# Autodesk Inventor assembly: Assembly1
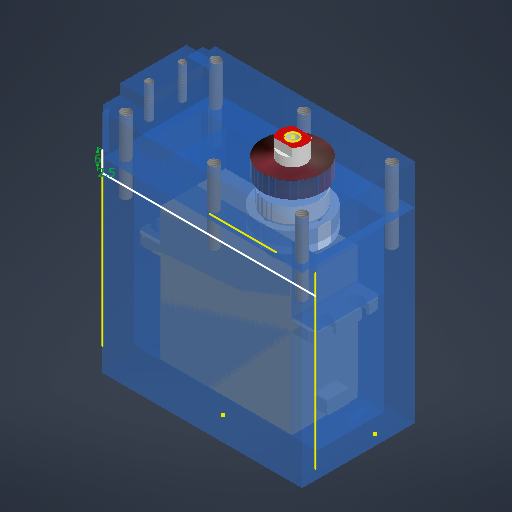
[picture p0: Inventor's stored thumbnail of the model, 512x512]
Saved by Autodesk Inventor 2027 (Build 310192060, 192F)
## iProperties
Created: 2026-08-12
Part Number: Assembly1
Document SubType Name: Assembly
Designer: Laptop
Author: Laptop
## iProperties of the stored document Servo_8120MG.iam
Company: none
Created: 2026-04-17
Part Number: Product3
Description: CATIA V5 STEP Exchange
Document SubType Name: Assembly
Designer: Laptop
Authority: none
Sending System: CATIA V5 STEP AP214 v3
Preprocessor: CATIA Version 5-6 Release 2023 SP4
Title: D:\Work it\EcoLid\V9_new Gen\Servo_8120MG.stp
Author: none
## iProperties of the stored document servo motor_8120MG.ipt
Created: 2026-08-12
Part Number: servo motor_8120MG
Material: Generic
Document SubType Name: Modeling
Designer: Laptop
Density: 1 g/cm^3
Appearance: Default
Author: Laptop
## iProperties of the stored document Servo horn v2.ipt
Created: 2026-08-12
Part Number: Servo horn
Material: Generic
Document SubType Name: Modeling
Designer: Laptop
Density: 1 g/cm^3
Appearance: Default
Author: Laptop
## Documents named in this file (11)
- D:\Downloads\Assembly1.iam
- **D:\Downloads\Assembly1.iam*LocalDocs*xAaaaavbaAaaaaaaaAaaaayyeQa*Servo_8120MG.iam
- D:\Year2\đồ án tốt nghịp\3d\cátrục (1).ipt
- D:\Year2\đồ án tốt nghịp\3d\cáhộp servo (2) (1).ipt
- D:\Year2\đồ án tốt nghịp\3d\cánap tren servo_MIR_MIR.ipt
- D:\Year2\đồ án tốt nghịp\servo-motor_8120mg-1.snapshot.2\bạc đạn 8x16x5 2rs.ipt
- D:\Year2\đồ án tốt nghịp\servo-motor_8120mg-1.snapshot.2\phớt chặn dầu 8x18x5.ipt
- D:\Year2\đồ án tốt nghịp\servo-motor_8120mg-1.snapshot.2\Servo-9imod-DS35MG-180.ipt
- D:\Year2\đồ án tốt nghịp\servo-motor_8120mg-1.snapshot.2\Servo_8120MG.stp
- **D:\Downloads\Assembly1.iam*LocalDocs*xAaaaqedaAaaaaaaaAaaaap5mWf*Servo horn v2.ipt
- **D:\Downloads\Assembly1.iam*LocalDocs*xAaaaapbaAaaaaaaaAaaaqywvQd*servo motor_8120MG.ipt
## Components (7 placed, 7 different names)
1. cáhộp servo (2) (1):1 — Mate:20, Mate:21
2. cánap tren servo_MIR_MIR:1 — Mate:20, Mate:21, Mate:22, Flush:1
3. bạc đạn 8x16x5 2rs:1 — Mate:23, Mate:24
4. phớt chặn dầu 8x18x5:1 — Mate:22, Flush:1
5. Servo_8120MG:1 [sub-assembly] — Mate:14, Mate:15, Mate:16, Mate:17
6. cátrục (1):1 — Mate:16, Mate:17, Mate:23, Mate:24
7. Servo-9imod-DS35MG-180:1 — Mate:14, Mate:15
## Relationships (10: Mate 9, Flush 1)
- Mate:14 (0.5 mm): Servo_8120MG:1 ↔ Servo-9imod-DS35MG-180:1
- Mate:15: Servo_8120MG:1 ↔ Servo-9imod-DS35MG-180:1
- Mate:16: Servo_8120MG:1 ↔ cátrục (1):1
- Mate:17: Servo_8120MG:1 ↔ cátrục (1):1
- Mate:20: cáhộp servo (2) (1):1 ↔ cánap tren servo_MIR_MIR:1
- Mate:21: cáhộp servo (2) (1):1 ↔ cánap tren servo_MIR_MIR:1
- Mate:22: cánap tren servo_MIR_MIR:1 ↔ phớt chặn dầu 8x18x5:1
- Flush:1: cánap tren servo_MIR_MIR:1 ↔ phớt chặn dầu 8x18x5:1
- Mate:23: bạc đạn 8x16x5 2rs:1 ↔ cátrục (1):1
- Mate:24: bạc đạn 8x16x5 2rs:1 ↔ cátrục (1):1
## Named parameters: Finish1_Area = 32.64, Finish2_Area = 32.1565, Finish3_Area = 228.404, Finish4_Area = 100.512, Finish5_Area = 0.333911
note: some values were not read from the file. Shown as the stored number, unit unknown: "Finish1_Area", "Finish2_Area", "Finish3_Area", "Finish4_Area", "Finish5_Area".
